# Autodesk Inventor assembly: Charging Cable Assembly
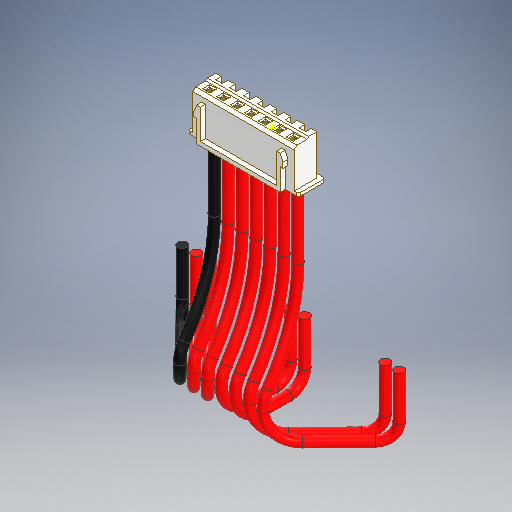
[picture p0: Inventor's stored thumbnail of the model, 512x512]
Saved by Autodesk Inventor 2025 (Build 290162010, 162A)
## iProperties
Created: 2025-08-20
Part Number: Charging Cable Assembly
Document SubType Name: Assembly
Designer: Glen Collingwood
Author: Glen Collingwood
## Documents named in this file (3)
- D:\MISCELLANEOUS\Inventor Projects\SSN 744 Block V (1-100)\Battery\Charging Cable Assembly.iam
- D:\MISCELLANEOUS\Inventor Projects\SSN 744 Block V (1-100)\Connectors\JST XHP-7 Female.ipt
- D:\MISCELLANEOUS\Inventor Projects\SSN 744 Block V (1-100)\Connectors\Charging Cables.ipt
## Components (2 placed, 2 different names)
1. JST XHP-7 Female:1 — Flush:1, Mate:1, Mate:2, Mate:3, Mate:5, Mate:6, Mate:7, Mate:8, Flush:2
2. Charging Cables:1 — Mate:7, Mate:8, Flush:2
## Relationships (10: Mate 8, Flush 2)
- Flush:1: JST XHP-7 Female:1
- Mate:1: JST XHP-7 Female:1
- Mate:2: JST XHP-7 Female:1
- Mate:3: JST XHP-7 Female:1
- Mate:4
- Mate:5: JST XHP-7 Female:1
- Mate:6: JST XHP-7 Female:1
- Mate:7: JST XHP-7 Female:1 ↔ Charging Cables:1
- Mate:8: JST XHP-7 Female:1 ↔ Charging Cables:1
- Flush:2 (-1 mm): JST XHP-7 Female:1 ↔ Charging Cables:1
